# Autodesk Inventor assembly: Camera_holder
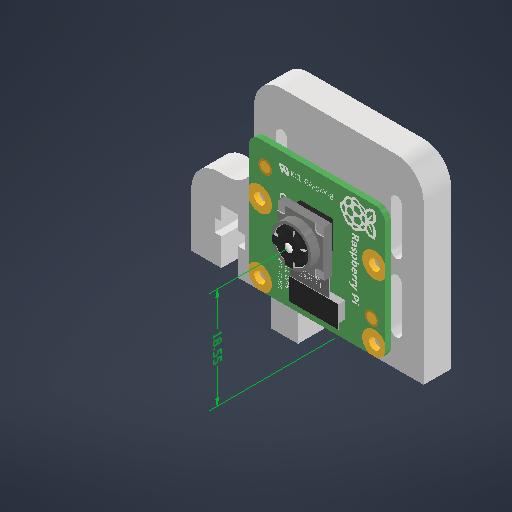
[picture p0: Inventor's stored thumbnail of the model, 512x512]
Saved by Autodesk Inventor 2026.3 (Build 303398000, 398)
## iProperties
Created: 2026-08-20
Part Number: Camera_holder
Document SubType Name: Assembly
Designer: nose
Author: nose
## Documents named in this file (3)
- C:\Workspace\summer_robotics_project\TEST\CAD\EXTRA\Assembly\Camera_holder.iam
- C:\Workspace\summer_robotics_project\TEST\CAD\EXTRA\Camera_holder.ipt
- C:\Workspace\summer_robotics_project\TEST\CAD\EXTRA\DOWNLOAD\Raspberry pi 3 cam V2,1\Cam V2.1 v1\Cam V2.1 v1.ipt
## Components (2 placed, 2 different names)
1. Camera_holder:1 — Insert:1, Insert:2
2. Cam V2.1 v1:1 — Insert:1, Insert:2
## Relationships (2: Insert 2)
- Insert:1 (3 mm): Camera_holder:1 ↔ Cam V2.1 v1:1
- Insert:2 (3 mm): Camera_holder:1 ↔ Cam V2.1 v1:1
